# Autodesk Inventor assembly: ControlBox
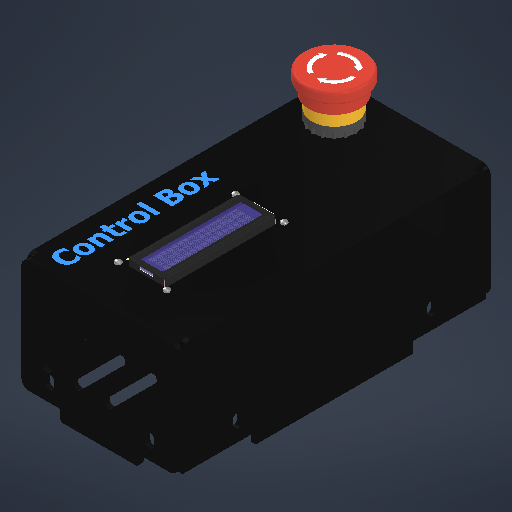
[picture p0: Inventor's stored thumbnail of the model, 512x512]
Saved by Autodesk Inventor 2027.1 (Build 311270010, 270A)
## iProperties
Created: 2026-10-13
Part Number: ControlBox
Document SubType Name: Assembly
Designer: SDS Scholar
Author: SDS Scholar
## Documents named in this file (8)
- C:\Users\Ahmed\Desktop\Fall 26\Design 1 Repo\MCT333_Design_of_Mechatronics_Systems_1\CAD\boxes\control_box\ControlBox.iam
- C:\Users\Ahmed\Desktop\Fall 26\Design 1 Repo\MCT333_Design_of_Mechatronics_Systems_1\CAD\boxes\control_box\ControlBoxLengthFace.ipt
- C:\Users\Ahmed\Desktop\Fall 26\Design 1 Repo\MCT333_Design_of_Mechatronics_Systems_1\CAD\boxes\control_box\ControlBoxWidthFace.ipt
- C:\Users\Ahmed\Desktop\Fall 26\Design 1 Repo\MCT333_Design_of_Mechatronics_Systems_1\CAD\boxes\control_box\ControlBoxCeiling.ipt
- C:\Users\Ahmed\Desktop\Fall 26\Design 1 Repo\MCT333_Design_of_Mechatronics_Systems_1\CAD\electronic_components\character_lcd_display_16x2\DFRobot_1602_LCD\DFRobot_1602_LCD.ipt
- C:\Users\Ahmed\Desktop\Fall 26\Design 1 Repo\MCT333_Design_of_Mechatronics_Systems_1\CAD\fastners\bolts\m2\EN ISO 7045 - M2 x 10 - 4.8 - Z.ipt
- C:\Users\Ahmed\Desktop\Fall 26\Design 1 Repo\MCT333_Design_of_Mechatronics_Systems_1\CAD\fastners\nuts\ANSI B 18.2.4.1 M - M2 x 0.4Style 1.ipt
- C:\Users\Ahmed\Desktop\Fall 26\Design 1 Repo\MCT333_Design_of_Mechatronics_Systems_1\CAD\electronic_components\emergency_stop_switch_button\Emergency stop switch\Emergency stop switch.ipt
## Components (15 placed, 7 different names)
1. Emergency stop switch:1 — Mate:14, Mate:15, Angle:1
2. ControlBoxLengthFace:1 — Flush:1, Mate:3, Flush:3, Flush:4, Flush:5, Flush:6, Flush:8, Flush:9, Flush:10, Flush:11, Flush:14, Symmetry:2
3. ControlBoxLengthFace:2 — Flush:5, Flush:12, Flush:13, Flush:16, Symmetry:2
4. ControlBoxWidthFace:1 — Flush:6, Flush:9, Flush:11, Angle:1, Symmetry:1
5. ControlBoxWidthFace:2 — Flush:4, Flush:8, Flush:10, Flush:12, Flush:13, Flush:15, Symmetry:1
6. ControlBoxCeiling:1 — Flush:14, Flush:15, Flush:16, Mate:5, Mate:6, Mate:7, Mate:11, Mate:12, Mate:14, Mate:15
7. DFRobot_1602_LCD:1 — Mate:5, Mate:6, Mate:7, Mate:10
8. BS EN ISO 7045 Z - Metric M2 x 10 - 4.8 - Z:5 — Mate:11, Mate:12, Mate:13
9. Hex Nut Metric M2 x 0.4:5 — Mate:10, Mate:13
10. BS EN ISO 7045 Z - Metric M2 x 10 - 4.8 - Z:6
11. Hex Nut Metric M2 x 0.4:6
12. BS EN ISO 7045 Z - Metric M2 x 10 - 4.8 - Z:7
13. Hex Nut Metric M2 x 0.4:7
14. BS EN ISO 7045 Z - Metric M2 x 10 - 4.8 - Z:8
15. Hex Nut Metric M2 x 0.4:8
## Component patterns: (4 elements, first: BS EN ISO 7045 Z - Metric M2 x 10 - 4.8 - Z:5 + Hex Nut Metric M2 x 0.4:5)
## Relationships (27: Flush 14, Mate 10, Symmetry 2, Angle 1)
- Flush:1 (2.054 mm): ControlBoxLengthFace:1
- Mate:3: ControlBoxLengthFace:1
- Flush:3: ControlBoxLengthFace:1
- Flush:4: ControlBoxLengthFace:1 ↔ ControlBoxWidthFace:2
- Flush:5: ControlBoxLengthFace:1 ↔ ControlBoxLengthFace:2
- Flush:6: ControlBoxLengthFace:1 ↔ ControlBoxWidthFace:1
- Flush:8: ControlBoxLengthFace:1 ↔ ControlBoxWidthFace:2
- Flush:9: ControlBoxLengthFace:1 ↔ ControlBoxWidthFace:1
- Flush:10: ControlBoxLengthFace:1 ↔ ControlBoxWidthFace:2
- Flush:11: ControlBoxLengthFace:1 ↔ ControlBoxWidthFace:1
- Flush:12: ControlBoxLengthFace:2 ↔ ControlBoxWidthFace:2
- Flush:13: ControlBoxLengthFace:2 ↔ ControlBoxWidthFace:2
- Flush:14: ControlBoxLengthFace:1 ↔ ControlBoxCeiling:1
- Flush:15: ControlBoxWidthFace:2 ↔ ControlBoxCeiling:1
- Flush:16: ControlBoxLengthFace:2 ↔ ControlBoxCeiling:1
- Mate:5: ControlBoxCeiling:1 ↔ DFRobot_1602_LCD:1
- Mate:6: ControlBoxCeiling:1 ↔ DFRobot_1602_LCD:1
- Mate:7: ControlBoxCeiling:1 ↔ DFRobot_1602_LCD:1
- Mate:10: DFRobot_1602_LCD:1 ↔ Hex Nut Metric M2 x 0.4:5
- Mate:11: ControlBoxCeiling:1 ↔ BS EN ISO 7045 Z - Metric M2 x 10 - 4.8 - Z:5
- Mate:12: ControlBoxCeiling:1 ↔ BS EN ISO 7045 Z - Metric M2 x 10 - 4.8 - Z:5
- Mate:13: BS EN ISO 7045 Z - Metric M2 x 10 - 4.8 - Z:5 ↔ Hex Nut Metric M2 x 0.4:5
- Mate:14: Emergency stop switch:1 ↔ ControlBoxCeiling:1
- Mate:15: Emergency stop switch:1 ↔ ControlBoxCeiling:1
- Angle:1 (180 deg): Emergency stop switch:1 ↔ ControlBoxWidthFace:1
- Symmetry:1: ControlBoxWidthFace:1 ↔ ControlBoxWidthFace:2
- Symmetry:2: ControlBoxLengthFace:1 ↔ ControlBoxLengthFace:2
